# Autodesk Inventor assembly: MainBody_Assembly_Visual_simple
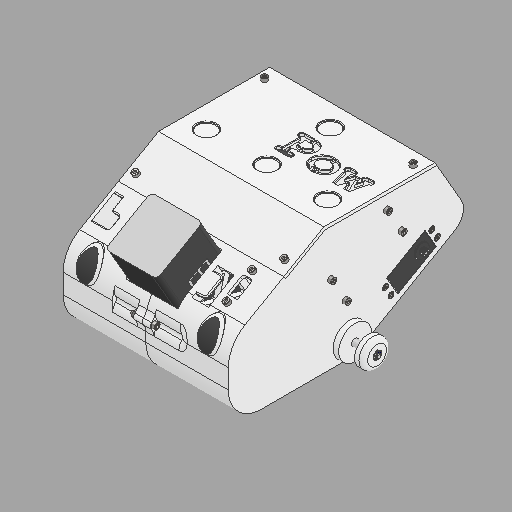
[picture p0: Inventor's stored thumbnail of the model, 512x512]
Saved by Autodesk Inventor 2025 (Build 290162000, 162)
## iProperties
Created: 2024-11-15
Part Number: MainBody_Assembly_Visual_simple
Document SubType Name: Assembly
Designer: OSB
Mass: 1414.04 g
Surface Area: 4558.62 cm^2
Volume: 1064.8 cm^3
Density: 1.32799 g/cm^3
Sending System: Autodesk Inventor 2021
Preprocessor: unknown
Minimum Resolution: 0.01
Sent Units: Millimeter
Translation Standard: IGES 5.3
Model Creation Time: 2020-07-07
Title: S500 Frame
Author: OSB
## Documents named in this file (14)
- C:\Users\OSB\Desktop\SB\1.Projects\캡스톤 디자인(2)_Paper\Modeling\Implementation_Design\Ver_003_mass_update\MainBody_Assembly_Visual_simple.iam
- C:\Users\OSB\Desktop\SB\1.Projects\캡스톤 디자인(2)_Paper\Modeling\Implementation_Design\Ver_003_mass_update\MainBody_Left.ipt
- C:\Users\OSB\Desktop\SB\1.Projects\캡스톤 디자인(2)_Paper\Modeling\Implementation_Design\Ver_003_mass_update\MainBody_Right.ipt
- C:\Users\OSB\Documents\Inventor\Content Center Files\R2025\ko-KR\KS B 1003\KS B 1003 - M 3 x 20.ipt
- C:\Users\OSB\Documents\Inventor\Content Center Files\R2025\ko-KR\KS B 1012  S2 F\KS B 1012 - M 3(1).ipt
- C:\Users\OSB\Desktop\SB\1.Projects\캡스톤 디자인(2)_Paper\Modeling\Implementation_Design\Ver_003_mass_update\InsertNut_M3.ipt
- C:\Users\OSB\Desktop\SB\1.Projects\캡스톤 디자인(2)_Paper\Modeling\Implementation_Design\Ver_003_mass_update\Servo_Hip_Assembly.iam
- C:\Users\OSB\Documents\Inventor\Content Center Files\R2025\ko-KR\KS B 1003\KS B 1003 - M 3 x 10.ipt
- C:\Users\OSB\Documents\Inventor\Content Center Files\R2025\ko-KR\KS B 1003\KS B 1003 - M 2.5 x 16.ipt
- C:\Users\OSB\Desktop\SB\1.Projects\캡스톤 디자인(2)_Paper\Modeling\Implementation_Design\Ver_003_mass_update\ShoulderBolt.ipt
- C:\Users\OSB\Desktop\SB\1.Projects\캡스톤 디자인(2)_Paper\Modeling\Implementation_Design\Ver_003_mass_update\Battery_LiPo_6S_Pack.ipt
- C:\Users\OSB\Desktop\SB\1.Projects\캡스톤 디자인(2)_Paper\Modeling\Implementation_Design\Ver_003_mass_update\MainBody_TopCover.ipt
- C:\Users\OSB\Desktop\SB\1.Projects\캡스톤 디자인(2)_Paper\Modeling\Implementation_Design\Ver_003_mass_update\Spacer_Joint_Assembly.ipt.iam
- Spacer_Joint_Assembly.ipt
## Components (52 placed, 12 different names)
1. MainBody_Left:1 — 회전:1, 메이트:1, 삽입:1, 삽입:2, 삽입:3, 삽입:4, 강체:3, 강체:4, 강체:7, 강체:8, 강체:9, 삽입:9, 삽입:10, 삽입:11, 삽입:12, 삽입:13, 삽입:14, 회전:8, 메이트:11, 삽입:21, 삽입:22, 삽입:23, 삽입:24, 강체:12, 메이트:13, 메이트:14
2. MainBody_Right:1 — 회전:1, 메이트:1, 삽입:5, 삽입:6, 삽입:7, 삽입:8, 강체:1, 강체:2, 강체:5, 강체:6, 강체:10, 삽입:15, 삽입:16, 삽입:17, 삽입:18, 삽입:19, 삽입:20, 회전:9, 메이트:12, 삽입:25, 삽입:26, 삽입:27, 삽입:28, 강체:11, 메이트:15
3. MainBody_TopCover:1 — 회전:10, 메이트:16, 삽입:29, 삽입:30, 삽입:31, 삽입:32
4. Servo_Hip_Assembly:1 [sub-assembly] — 회전:8, 메이트:11
5. Servo_Hip_Assembly:2 [sub-assembly] — 회전:9, 메이트:12
6. Battery_LiPo_6S_Pack:1 — 메이트:13, 메이트:14, 메이트:15
7. ShoulderBolt:1 — 강체:11
8. ShoulderBolt:2 — 강체:12
9. Spacer_Joint_Assembly.ipt:1 [sub-assembly]
10. Spacer_Joint_Assembly.ipt:2 [sub-assembly]
11. KS B 1003 - 미터 M 3 x 20:1 — 삽입:1
12. KS B 1003 - 미터 M 3 x 20:2 — 삽입:2
13. KS B 1003 - 미터 M 3 x 20:3 — 삽입:3
14. KS B 1003 - 미터 M 3 x 20:4 — 삽입:4
15. KS B 1003 - 미터 M 3 x 10:13 — 삽입:29
16. KS B 1003 - 미터 M 3 x 10:14 — 삽입:30
17. KS B 1003 - 미터 M 3 x 10:15 — 삽입:31
18. KS B 1003 - 미터 M 3 x 10:16 — 삽입:32
19. KS B 1003 - 미터 M 3 x 10:1 — 삽입:9
20. KS B 1003 - 미터 M 3 x 10:2 — 삽입:10
21. KS B 1003 - 미터 M 3 x 10:3 — 삽입:11
22. KS B 1003 - 미터 M 3 x 10:4 — 삽입:12
23. KS B 1003 - 미터 M 3 x 10:6 — 삽입:13
24. KS B 1003 - 미터 M 3 x 10:5 — 삽입:14
25. KS B 1003 - 미터 M 3 x 10:7 — 삽입:15
26. KS B 1003 - 미터 M 3 x 10:12 — 삽입:16
27. KS B 1003 - 미터 M 3 x 10:11 — 삽입:17
28. KS B 1003 - 미터 M 3 x 10:8 — 삽입:18
29. KS B 1003 - 미터 M 3 x 10:9 — 삽입:19
30. KS B 1003 - 미터 M 3 x 10:10 — 삽입:20
31. KS B 1003 - 미터 M 2.5 x 16:8 — 삽입:21
32. KS B 1003 - 미터 M 2.5 x 16:7 — 삽입:22
33. KS B 1003 - 미터 M 2.5 x 16:6 — 삽입:23
34. KS B 1003 - 미터 M 2.5 x 16:5 — 삽입:24
35. KS B 1003 - 미터 M 2.5 x 16:1 — 삽입:25
36. KS B 1003 - 미터 M 2.5 x 16:4 — 삽입:26
37. KS B 1003 - 미터 M 2.5 x 16:2 — 삽입:27
38. KS B 1003 - 미터 M 2.5 x 16:3 — 삽입:28
39. InsertNut_M3:1 — 강체:5
40. InsertNut_M3:2 — 강체:4, 회전:10
41. InsertNut_M3:3 — 강체:1, 메이트:16
42. InsertNut_M3:4 — 강체:3
43. InsertNut_M3:5 — 강체:2
44. InsertNut_M3:6 — 강체:6
45. InsertNut_M3:7 — 강체:7
46. InsertNut_M3:8 — 강체:8
47. InsertNut_M3:9 — 강체:9
48. InsertNut_M3:10 — 강체:10
49. KS B 1012 스타일 2 다듬질 - 미터 M 3:1 — 삽입:5
50. KS B 1012 스타일 2 다듬질 - 미터 M 3:2 — 삽입:6
51. KS B 1012 스타일 2 다듬질 - 미터 M 3:3 — 삽입:7
52. KS B 1012 스타일 2 다듬질 - 미터 M 3:4 — 삽입:8
## Relationships (55: Insert 32, WeldJoint 12, Mate 7, RevoluteJoint 4)
- 회전:1 [RevoluteJoint]: MainBody_Left:1 ↔ MainBody_Right:1
- 메이트:1 [Mate]: MainBody_Left:1 ↔ MainBody_Right:1
- 삽입:1 [Insert]: MainBody_Left:1 ↔ KS B 1003 - 미터 M 3 x 20:1
- 삽입:2 [Insert]: MainBody_Left:1 ↔ KS B 1003 - 미터 M 3 x 20:2
- 삽입:3 [Insert]: MainBody_Left:1 ↔ KS B 1003 - 미터 M 3 x 20:3
- 삽입:4 [Insert]: MainBody_Left:1 ↔ KS B 1003 - 미터 M 3 x 20:4
- 삽입:5 [Insert]: MainBody_Right:1 ↔ KS B 1012 스타일 2 다듬질 - 미터 M 3:1
- 삽입:6 [Insert]: MainBody_Right:1 ↔ KS B 1012 스타일 2 다듬질 - 미터 M 3:2
- 삽입:7 [Insert]: MainBody_Right:1 ↔ KS B 1012 스타일 2 다듬질 - 미터 M 3:3
- 삽입:8 [Insert]: MainBody_Right:1 ↔ KS B 1012 스타일 2 다듬질 - 미터 M 3:4
- 강체:1 [WeldJoint]: MainBody_Right:1 ↔ InsertNut_M3:3
- 강체:2 [WeldJoint]: MainBody_Right:1 ↔ InsertNut_M3:5
- 강체:3 [WeldJoint]: MainBody_Left:1 ↔ InsertNut_M3:4
- 강체:4 [WeldJoint]: MainBody_Left:1 ↔ InsertNut_M3:2
- 강체:5 [WeldJoint]: MainBody_Right:1 ↔ InsertNut_M3:1
- 강체:6 [WeldJoint]: MainBody_Right:1 ↔ InsertNut_M3:6
- 강체:7 [WeldJoint]: MainBody_Left:1 ↔ InsertNut_M3:7
- 강체:8 [WeldJoint]: MainBody_Left:1 ↔ InsertNut_M3:8
- 강체:9 [WeldJoint]: MainBody_Left:1 ↔ InsertNut_M3:9
- 강체:10 [WeldJoint]: MainBody_Right:1 ↔ InsertNut_M3:10
- 삽입:9 [Insert]: MainBody_Left:1 ↔ KS B 1003 - 미터 M 3 x 10:1
- 삽입:10 [Insert]: MainBody_Left:1 ↔ KS B 1003 - 미터 M 3 x 10:2
- 삽입:11 [Insert]: MainBody_Left:1 ↔ KS B 1003 - 미터 M 3 x 10:3
- 삽입:12 [Insert]: MainBody_Left:1 ↔ KS B 1003 - 미터 M 3 x 10:4
- 삽입:13 [Insert]: MainBody_Left:1 ↔ KS B 1003 - 미터 M 3 x 10:6
- 삽입:14 [Insert]: MainBody_Left:1 ↔ KS B 1003 - 미터 M 3 x 10:5
- 삽입:15 [Insert]: MainBody_Right:1 ↔ KS B 1003 - 미터 M 3 x 10:7
- 삽입:16 [Insert]: MainBody_Right:1 ↔ KS B 1003 - 미터 M 3 x 10:12
- 삽입:17 [Insert]: MainBody_Right:1 ↔ KS B 1003 - 미터 M 3 x 10:11
- 삽입:18 [Insert]: MainBody_Right:1 ↔ KS B 1003 - 미터 M 3 x 10:8
- 삽입:19 [Insert]: MainBody_Right:1 ↔ KS B 1003 - 미터 M 3 x 10:9
- 삽입:20 [Insert]: MainBody_Right:1 ↔ KS B 1003 - 미터 M 3 x 10:10
- 회전:8 [RevoluteJoint]: MainBody_Left:1 ↔ Servo_Hip_Assembly:1
- 메이트:11 [Mate]: MainBody_Left:1 ↔ Servo_Hip_Assembly:1
- 회전:9 [RevoluteJoint]: MainBody_Right:1 ↔ Servo_Hip_Assembly:2
- 메이트:12 [Mate]: MainBody_Right:1 ↔ Servo_Hip_Assembly:2
- 삽입:21 [Insert]: MainBody_Left:1 ↔ KS B 1003 - 미터 M 2.5 x 16:8
- 삽입:22 [Insert]: MainBody_Left:1 ↔ KS B 1003 - 미터 M 2.5 x 16:7
- 삽입:23 [Insert]: MainBody_Left:1 ↔ KS B 1003 - 미터 M 2.5 x 16:6
- 삽입:24 [Insert]: MainBody_Left:1 ↔ KS B 1003 - 미터 M 2.5 x 16:5
- 삽입:25 [Insert]: MainBody_Right:1 ↔ KS B 1003 - 미터 M 2.5 x 16:1
- 삽입:26 [Insert]: MainBody_Right:1 ↔ KS B 1003 - 미터 M 2.5 x 16:4
- 삽입:27 [Insert]: MainBody_Right:1 ↔ KS B 1003 - 미터 M 2.5 x 16:2
- 삽입:28 [Insert]: MainBody_Right:1 ↔ KS B 1003 - 미터 M 2.5 x 16:3
- 강체:11 [WeldJoint]: MainBody_Right:1 ↔ ShoulderBolt:1
- 강체:12 [WeldJoint]: MainBody_Left:1 ↔ ShoulderBolt:2
- 메이트:13 [Mate]: MainBody_Left:1 ↔ Battery_LiPo_6S_Pack:1
- 메이트:14 [Mate]: MainBody_Left:1 ↔ Battery_LiPo_6S_Pack:1
- 메이트:15 [Mate]: MainBody_Right:1 ↔ Battery_LiPo_6S_Pack:1
- 회전:10 [RevoluteJoint]: MainBody_TopCover:1 ↔ InsertNut_M3:2
- 메이트:16 [Mate]: MainBody_TopCover:1 ↔ InsertNut_M3:3
- 삽입:29 [Insert]: MainBody_TopCover:1 ↔ KS B 1003 - 미터 M 3 x 10:13
- 삽입:30 [Insert]: MainBody_TopCover:1 ↔ KS B 1003 - 미터 M 3 x 10:14
- 삽입:31 [Insert]: MainBody_TopCover:1 ↔ KS B 1003 - 미터 M 3 x 10:15
- 삽입:32 [Insert]: MainBody_TopCover:1 ↔ KS B 1003 - 미터 M 3 x 10:16
